# Autodesk Inventor assembly: 灯板装配
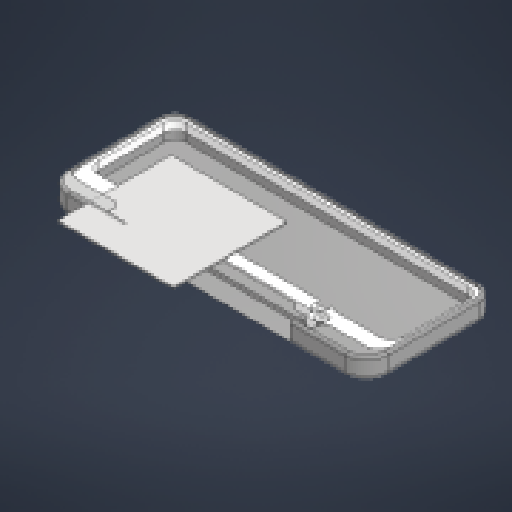
[picture p0: Inventor's stored thumbnail of the model, 512x512]
Saved by Autodesk Inventor 2025 (Build 290162000, 162)
## iProperties
Created: 2009-02-10
Part Number: 灯板装配
Document SubType Name: Assembly
Designer: HZD
Sending System: SolidWorks 2016
Last Author: 23171
Last Saved: 2025-11-01
Author: HZD
## Documents named in this file (4)
- D:\2 B Mechanical design\Bright\灯板装配.iam
- D:\2 B Mechanical design\Bright\灯板外壳.ipt
- D:\2 B Mechanical design\Bright\柔光膜固定板.ipt
- D:\2 B Mechanical design\Bright\更新图纸\灯板更新\亚克力.ipt
## Components (3 placed, 3 different names)
1. 灯板外壳:1 — 配合:1, 配合:2
2. 柔光膜固定板:2 — 配合:1, 配合:2, 配合:3
3. 亚克力:1 — 配合:3
## Relationships (3: Mate 3)
- 配合:1 [Mate]: 灯板外壳:1 ↔ 柔光膜固定板:2
- 配合:2 [Mate]: 灯板外壳:1 ↔ 柔光膜固定板:2
- 配合:3 [Mate]: 柔光膜固定板:2 ↔ 亚克力:1
